# Autodesk Inventor assembly: engranes
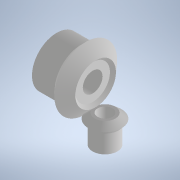
[picture p0: Inventor's stored thumbnail of the model, 180x180]
Saved by Autodesk Inventor 2021 (Build 250183000, 183)
## iProperties
Created: 2026-03-24
Part Number: engranes
Document SubType Name: Assembly
Designer: thepr
Author: thepr
## Documents named in this file (3)
- C:\Users\thepr\OneDrive\Escritorio\Memoria\DEDO_final\engranes.iam
- C:\Users\thepr\OneDrive\Escritorio\Memoria\DEDO_final\12T.ipt
- C:\Users\thepr\OneDrive\Escritorio\Memoria\DEDO_final\24T.ipt
## Components (2 placed, 2 different names)
1. 12T:1 — Coincidencia:1, Coincidencia:2, Nivelación:3
2. 24T:1 — Coincidencia:3, Nivelación:2, Nivelación:4
## Relationships (7: Flush 4, Mate 3)
- Coincidencia:1 [Mate]: 12T:1
- Coincidencia:2 [Mate]: 12T:1
- Nivelación:1 [Flush] (-4.8 mm)
- Coincidencia:3 [Mate]: 24T:1
- Nivelación:2 [Flush]: 24T:1
- Nivelación:3 [Flush] (6.3 mm): 12T:1
- Nivelación:4 [Flush]: 24T:1
